# Autodesk Inventor assembly: Assey_Paradox_Planetary_Gear_Power_Module
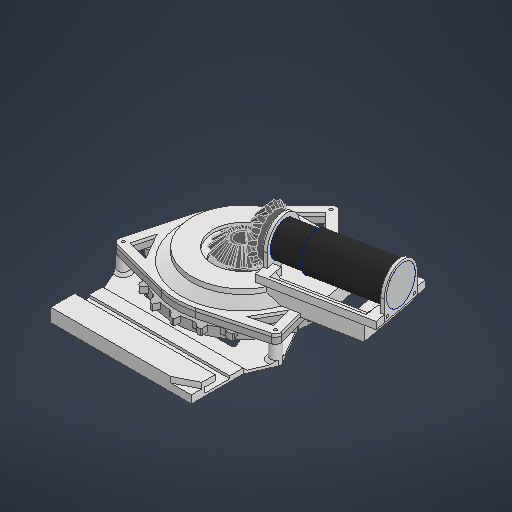
[picture p0: Inventor's stored thumbnail of the model, 512x512]
Saved by Autodesk Inventor 2027.1 (Build 311270010, 270A)
## iProperties
Created: 2026-11-11
Part Number: Assey_Paradox_Planetary_Gear_Power_Module
Document SubType Name: Assembly
Designer: takuya
Author: takuya
## Documents named in this file (3)
- D:\model\D2_Conveyor_2026\power_module\Paradox Planetary Gear Reducer\Assey_Paradox_Planetary_Gear_Power_Module.iam
- D:\model\D2_Conveyor_2026\power_module\Paradox Planetary Gear Reducer\gear_box.iam
- D:\model\D2_Conveyor_2026\power_module\Paradox Planetary Gear Reducer\Gears\Assey_Paradox_Planetary_Gear_Power_Module\Gears.iam
## Components (2 placed, 2 different names)
1. gear_box:1 [sub-assembly] — 回転:1, メイト:1
2. Gears:1 [sub-assembly] — 回転:1, メイト:1
## Relationships (2: RevoluteJoint 1, Mate 1)
- 回転:1 [RevoluteJoint]: gear_box:1 ↔ Gears:1
- メイト:1 [Mate]: gear_box:1 ↔ Gears:1
